# Autodesk Inventor assembly: M5_unit
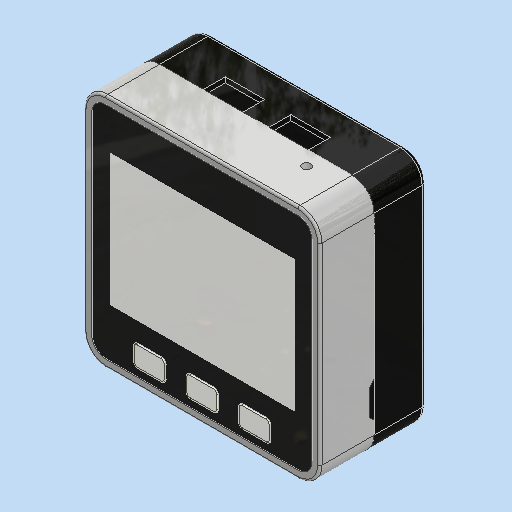
[picture p0: Inventor's stored thumbnail of the model, 512x512]
Saved by Autodesk Inventor 2025.3 (Build 293356030, 356C)
## iProperties
Created: 2025-08-01
Part Number: M5_unit
Document SubType Name: Assembly
Designer: ibuki_ono
Author: ibuki_ono
## Documents named in this file (3)
- C:\Users\ibuki_ono\Documents\hobby\rogiken\catchrobo\CAD\Hardware_CAD\Inventor\circuit\M5_unit.iam
- C:\Users\ibuki_ono\Documents\hobby\rogiken\catchrobo\CAD\Hardware_CAD\Inventor\circuit\M5Stack_v4\M5Stack_v4.ipt
- C:\Users\ibuki_ono\Documents\hobby\rogiken\catchrobo\CAD\Hardware_CAD\Inventor\circuit\M5_stack-lower.ipt
## Components (2 placed, 2 different names)
1. M5Stack_v4:1 — メイト:1, フラッシュ:1, フラッシュ:2
2. M5_stack-lower:1 — メイト:1, フラッシュ:1, フラッシュ:2
## Relationships (3: Flush 2, Mate 1)
- メイト:1 [Mate]: M5Stack_v4:1 ↔ M5_stack-lower:1
- フラッシュ:1 [Flush]: M5Stack_v4:1 ↔ M5_stack-lower:1
- フラッシュ:2 [Flush]: M5Stack_v4:1 ↔ M5_stack-lower:1
